# Autodesk Inventor assembly: Servo_unit
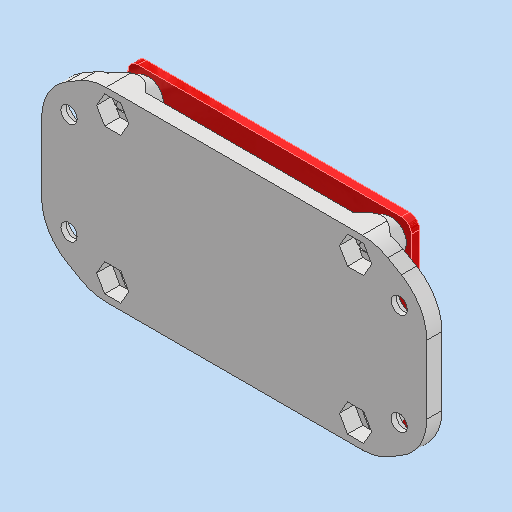
[picture p0: Inventor's stored thumbnail of the model, 512x512]
Saved by Autodesk Inventor 2025.3 (Build 293356030, 356C)
## iProperties
Created: 2025-08-01
Part Number: Servo_unit
Document SubType Name: Assembly
Designer: ibuki_ono
Author: ibuki_ono
## Documents named in this file (3)
- C:\Users\ibuki_ono\Documents\hobby\rogiken\catchrobo\CAD\Hardware_CAD\Inventor\circuit\Servo_unit.iam
- C:\Users\ibuki_ono\Documents\hobby\rogiken\catchrobo\CAD\Hardware_CAD\Inventor\circuit\Feetech-controller.ipt
- C:\Users\ibuki_ono\Documents\hobby\rogiken\catchrobo\CAD\Hardware_CAD\Inventor\circuit\3D_Feetech-controller-fix.ipt
## Components (2 placed, 2 different names)
1. Feetech-controller:1 — フラッシュ:1
2. 3D_Feetech-controller-fix:1 — フラッシュ:1
## Relationships (1: Flush 1)
- フラッシュ:1 [Flush]: Feetech-controller:1 ↔ 3D_Feetech-controller-fix:1
